# Autodesk Inventor assembly: 1112 TP-900x900x42
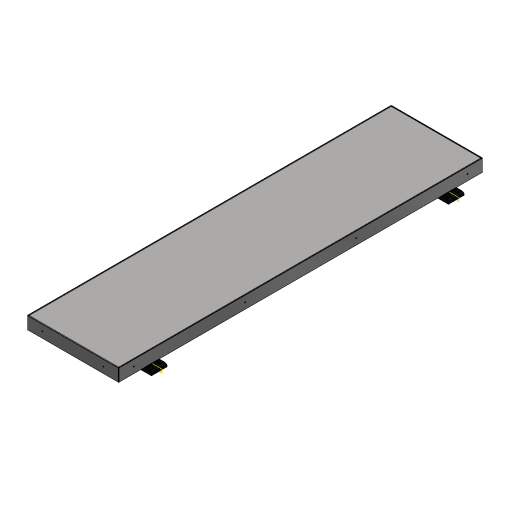
[picture p0: Inventor's stored thumbnail of the model, 512x512]
Saved by Autodesk Inventor 2024.3 (Build 283343000, 343)
## iProperties
RuleStatus: InUse
Created: 2019-06-24
Part Number: 1112 TP-900x900x42
Material: Generisch
Document SubType Name: Assembly
Designer: MK
Mass: 8457.82 g
Surface Area: 20524.5 cm^2
Volume: 1236.29 cm^3
Density: 6.84131 g/cm^3
Description: Tür-Paneel
InventorSizerSetup: TP 1T 1
Author: MK
## Documents named in this file (5)
- C:\Users\la\Documents\GitHub\Inventor_Sizer\C# Version\masters\TP\1T\1111 TP-300x1194x42.iam
- C:\Users\la\Documents\GitHub\Inventor_Sizer\C# Version\MODELS\Scharnier.iam
- C:\Users\la\Documents\GitHub\Inventor_Sizer\C# Version\MODELS\Türgriff abschließbar.iam
- C:\Users\la\Documents\GitHub\Inventor_Sizer\C# Version\masters\TP\1T\1111 300x1194x42-Au.ipt
- C:\Users\la\Documents\GitHub\Inventor_Sizer\C# Version\masters\TP\1T\1111 300x1194x42-In-2T.ipt
## Components (6 placed, 4 different names)
1. 1111 300x1194x42-Au:1 — Mate:6, Mate:7, Mate:8, Mate:9, Mate:10, Mate:11, Mate:12
2. 1111 300x1194x42-In-2T:1 — Mate:6, Mate:7, Mate:8
3. Türgriff abschließbar:4 [sub-assembly] — Mate:9, Mate:10, Mate:11
4. Türgriff abschließbar:5 [sub-assembly]
5. Scharnier:2 [sub-assembly] — Mate:12
6. Scharnier:3 [sub-assembly]
## Component patterns: (2 elements, first: Türgriff abschließbar:4), (2 elements, first: Scharnier:2)
## Relationships (7: Mate 7)
- Mate:6: 1111 300x1194x42-Au:1 ↔ 1111 300x1194x42-In-2T:1
- Mate:7 (0.5 mm): 1111 300x1194x42-Au:1 ↔ 1111 300x1194x42-In-2T:1
- Mate:8 (0.5 mm): 1111 300x1194x42-Au:1 ↔ 1111 300x1194x42-In-2T:1
- Mate:9: 1111 300x1194x42-Au:1 ↔ Türgriff abschließbar:4
- Mate:10: 1111 300x1194x42-Au:1 ↔ Türgriff abschließbar:4
- Mate:11: 1111 300x1194x42-Au:1 ↔ Türgriff abschließbar:4
- Mate:12: 1111 300x1194x42-Au:1 ↔ Scharnier:2
## Named parameters: Clearance = 0.5 mm, HingeCount = 2, HingePitch = 974 mm, HandleCount = 2, HandlePitch = 794 mm, Width = 300 mm
